# Autodesk Inventor assembly: 7_0_ASM_esthetique_PR
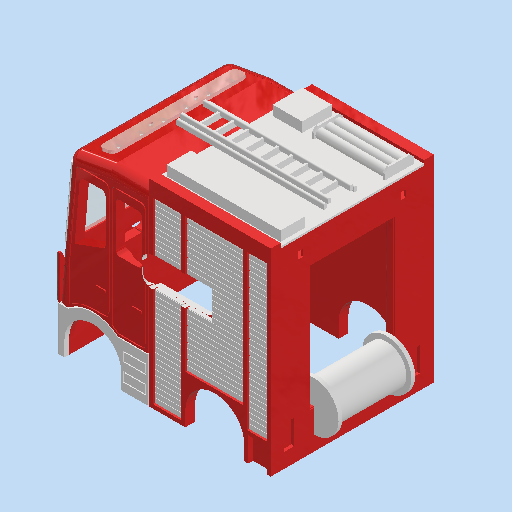
[picture p0: Inventor's stored thumbnail of the model, 512x512]
Saved by Autodesk Inventor 2026 (Build 300175050, 175E)
## iProperties
Created: 2025-06-21
Part Number: 7_0_ASM_esthetique_PR
Document SubType Name: Assembly
Designer: remg9
Author: remg9
## Documents named in this file (19)
- C:\Users\karle\OneDrive - HESSO\P2511_Dossier_partage_RVEZ\01_Robot\0101_CAO\7_esthétique\7_0_ASM_esthetique_PR.iam
- C:\Users\karle\OneDrive - HESSO\P2511_Dossier_partage_RVEZ\01_Robot\0101_CAO\7_esthétique\7_4_1_arriere_base.ipt
- C:\Users\karle\OneDrive - HESSO\P2511_Dossier_partage_RVEZ\01_Robot\0101_CAO\7_esthétique\7_1_1_cote_droit_base.ipt
- C:\Users\karle\OneDrive - HESSO\P2511_Dossier_partage_RVEZ\01_Robot\0101_CAO\7_esthétique\7_2_1_cote_gauche_base.ipt
- C:\Users\karle\OneDrive - HESSO\P2511_Dossier_partage_RVEZ\01_Robot\0101_CAO\7_esthétique\7_3_1_avant_base.ipt
- C:\Users\karle\OneDrive - HESSO\P2511_Dossier_partage_RVEZ\01_Robot\0101_CAO\7_esthétique\7_1_2_vollet_cote_avant.ipt
- C:\Users\karle\OneDrive - HESSO\P2511_Dossier_partage_RVEZ\01_Robot\0101_CAO\7_esthétique\7_1_3_vollet_cote_milieu.ipt
- C:\Users\karle\OneDrive - HESSO\P2511_Dossier_partage_RVEZ\01_Robot\0101_CAO\7_esthétique\7_1_4_vollet_cote_arriere.ipt
- C:\Users\karle\OneDrive - HESSO\P2511_Dossier_partage_RVEZ\01_Robot\0101_CAO\7_esthétique\7_1_5_tour_roue_avant_droite.ipt
- C:\Users\karle\OneDrive - HESSO\P2511_Dossier_partage_RVEZ\01_Robot\0101_CAO\7_esthétique\7_1_6_tour_roue_avant_gauche.ipt
- C:\Users\karle\OneDrive - HESSO\P2511_Dossier_partage_RVEZ\01_Robot\0101_CAO\7_esthétique\7_3_2_part_choc.ipt
- C:\Users\karle\OneDrive - HESSO\P2511_Dossier_partage_RVEZ\01_Robot\0101_CAO\7_esthétique\7_3_3_grille_avant.ipt
- C:\Users\karle\OneDrive - HESSO\P2511_Dossier_partage_RVEZ\01_Robot\0101_CAO\7_esthétique\7_5_1_toit_arriere.ipt
- C:\Users\karle\OneDrive - HESSO\P2511_Dossier_partage_RVEZ\01_Robot\0101_CAO\7_esthétique\7_5_2_toit_avant.ipt
- C:\Users\karle\OneDrive - HESSO\P2511_Dossier_partage_RVEZ\01_Robot\0101_CAO\7_esthétique\7_6_1_part_brise.ipt
- C:\Users\karle\OneDrive - HESSO\P2511_Dossier_partage_RVEZ\01_Robot\0101_CAO\7_esthétique\7_6_6_girophare.ipt
- C:\Users\karle\OneDrive - HESSO\P2511_Dossier_partage_RVEZ\01_Robot\0101_CAO\7_esthétique\7_4_2_devidoir.ipt
- C:\Users\karle\OneDrive - HESSO\P2511_Dossier_partage_RVEZ\01_Robot\0101_CAO\7_esthétique\7_5_3_1_echelle_bas.ipt
- C:\Users\karle\OneDrive - HESSO\P2511_Dossier_partage_RVEZ\01_Robot\0101_CAO\7_esthétique\7_5_3_2_echelle_haut.ipt
## Components (21 placed, 18 different names)
1. 7_4_1_arriere_base:1 — Fluchtend:1, Fluchtend:2, Fluchtend:3, Passend:1, Passend:2, Fluchtend:4, Fluchtend:5, Fluchtend:7, Passend:35, Fluchtend:8, Passend:43, Passend:44, Passend:45
2. 7_1_1_cote_droit_base:1 — Fluchtend:2, Passend:2, Passend:3, Fluchtend:5, Passend:8, Passend:9, Passend:10, Passend:17, Passend:18, Passend:19, Passend:20, Passend:21, Passend:22, Fluchtend:6, Fluchtend:7, Passend:26, Passend:27, Passend:28, Passend:41
3. 7_2_1_cote_gauche_base:1 — Fluchtend:1, Passend:1, Passend:4, Fluchtend:4, Passend:5, Passend:6, Passend:7, Passend:11, Passend:12, Passend:13, Passend:14, Passend:15, Passend:16, Passend:23, Passend:24, Passend:25, Passend:36, Passend:37, Fluchtend:9, Fluchtend:10, Passend:39
4. 7_3_1_avant_base:1 — Fluchtend:3, Passend:3, Passend:4, Fluchtend:6, Passend:29, Passend:30, Passend:32, Passend:33, Passend:34
5. 7_1_2_vollet_cote_avant:1 — Passend:20, Passend:21, Passend:22
6. 7_1_2_vollet_cote_avant:2 — Passend:11, Passend:12, Passend:13
7. 7_1_3_vollet_cote_milieu:1 — Passend:8, Passend:9, Passend:10
8. 7_1_3_vollet_cote_milieu:2 — Passend:5, Passend:6, Passend:7
9. 7_1_4_vollet_cote_arriere:1 — Passend:17, Passend:18, Passend:19
10. 7_1_4_vollet_cote_arriere:2 — Passend:14, Passend:15, Passend:16
11. 7_1_5_tour_roue_avant_droite:1 — Passend:26, Passend:27, Passend:28
12. 7_1_6_tour_roue_avant_gauche:1 — Passend:23, Passend:24, Passend:25, Passend:31
13. 7_3_2_part_choc:1 — Passend:29, Passend:30, Passend:31
14. 7_3_3_grille_avant:1 — Passend:32, Passend:33, Passend:34
15. 7_5_1_toit_arriere:1 — Passend:35, Passend:36, Fluchtend:8, Passend:38, Passend:46, Fluchtend:11, Passend:47
16. 7_5_2_toit_avant:1 — Passend:37, Fluchtend:9, Fluchtend:10, Passend:38, Passend:40, Passend:42, Einfügen:1, Einfügen:2
17. 7_6_1_part_brise:1 — Passend:39, Passend:40, Passend:41
18. 7_6_6_girophare:1 — Passend:42, Einfügen:1, Einfügen:2
19. 7_4_2_devidoir:1 — Passend:43, Passend:44, Passend:45
20. 7_5_3_1_echelle_bas:1 — Passend:46, Fluchtend:11, Passend:47, Fluchtend:12, Passend:48, Passend:49
21. 7_5_3_2_echelle_haut:1 — Fluchtend:12, Passend:48, Passend:49
## Relationships (63: Mate 49, Flush 12, Insert 2)
- Fluchtend:1 [Flush]: 7_4_1_arriere_base:1 ↔ 7_2_1_cote_gauche_base:1
- Fluchtend:2 [Flush]: 7_4_1_arriere_base:1 ↔ 7_1_1_cote_droit_base:1
- Fluchtend:3 [Flush]: 7_4_1_arriere_base:1 ↔ 7_3_1_avant_base:1
- Passend:1 [Mate]: 7_4_1_arriere_base:1 ↔ 7_2_1_cote_gauche_base:1
- Passend:2 [Mate]: 7_4_1_arriere_base:1 ↔ 7_1_1_cote_droit_base:1
- Passend:3 [Mate]: 7_1_1_cote_droit_base:1 ↔ 7_3_1_avant_base:1
- Passend:4 [Mate]: 7_2_1_cote_gauche_base:1 ↔ 7_3_1_avant_base:1
- Fluchtend:4 [Flush]: 7_4_1_arriere_base:1 ↔ 7_2_1_cote_gauche_base:1
- Fluchtend:5 [Flush]: 7_4_1_arriere_base:1 ↔ 7_1_1_cote_droit_base:1
- Passend:5 [Mate]: 7_2_1_cote_gauche_base:1 ↔ 7_1_3_vollet_cote_milieu:2
- Passend:6 [Mate] (1 mm): 7_2_1_cote_gauche_base:1 ↔ 7_1_3_vollet_cote_milieu:2
- Passend:7 [Mate] (1 mm): 7_2_1_cote_gauche_base:1 ↔ 7_1_3_vollet_cote_milieu:2
- Passend:8 [Mate]: 7_1_1_cote_droit_base:1 ↔ 7_1_3_vollet_cote_milieu:1
- Passend:9 [Mate] (1 mm): 7_1_1_cote_droit_base:1 ↔ 7_1_3_vollet_cote_milieu:1
- Passend:10 [Mate] (1 mm): 7_1_1_cote_droit_base:1 ↔ 7_1_3_vollet_cote_milieu:1
- Passend:11 [Mate]: 7_2_1_cote_gauche_base:1 ↔ 7_1_2_vollet_cote_avant:2
- Passend:12 [Mate] (1 mm): 7_2_1_cote_gauche_base:1 ↔ 7_1_2_vollet_cote_avant:2
- Passend:13 [Mate] (1 mm): 7_2_1_cote_gauche_base:1 ↔ 7_1_2_vollet_cote_avant:2
- Passend:14 [Mate]: 7_2_1_cote_gauche_base:1 ↔ 7_1_4_vollet_cote_arriere:2
- Passend:15 [Mate] (1 mm): 7_2_1_cote_gauche_base:1 ↔ 7_1_4_vollet_cote_arriere:2
- Passend:16 [Mate] (1 mm): 7_2_1_cote_gauche_base:1 ↔ 7_1_4_vollet_cote_arriere:2
- Passend:17 [Mate]: 7_1_1_cote_droit_base:1 ↔ 7_1_4_vollet_cote_arriere:1
- Passend:18 [Mate] (1 mm): 7_1_1_cote_droit_base:1 ↔ 7_1_4_vollet_cote_arriere:1
- Passend:19 [Mate] (1 mm): 7_1_1_cote_droit_base:1 ↔ 7_1_4_vollet_cote_arriere:1
- Passend:20 [Mate]: 7_1_1_cote_droit_base:1 ↔ 7_1_2_vollet_cote_avant:1
- Passend:21 [Mate] (1 mm): 7_1_1_cote_droit_base:1 ↔ 7_1_2_vollet_cote_avant:1
- Passend:22 [Mate] (1 mm): 7_1_1_cote_droit_base:1 ↔ 7_1_2_vollet_cote_avant:1
- Fluchtend:6 [Flush]: 7_1_1_cote_droit_base:1 ↔ 7_3_1_avant_base:1
- Fluchtend:7 [Flush]: 7_4_1_arriere_base:1 ↔ 7_1_1_cote_droit_base:1
- Passend:23 [Mate]: 7_2_1_cote_gauche_base:1 ↔ 7_1_6_tour_roue_avant_gauche:1
- Passend:24 [Mate] (1 mm): 7_2_1_cote_gauche_base:1 ↔ 7_1_6_tour_roue_avant_gauche:1
- Passend:25 [Mate] (1 mm): 7_2_1_cote_gauche_base:1 ↔ 7_1_6_tour_roue_avant_gauche:1
- Passend:26 [Mate]: 7_1_1_cote_droit_base:1 ↔ 7_1_5_tour_roue_avant_droite:1
- Passend:27 [Mate] (1 mm): 7_1_1_cote_droit_base:1 ↔ 7_1_5_tour_roue_avant_droite:1
- Passend:28 [Mate] (1 mm): 7_1_1_cote_droit_base:1 ↔ 7_1_5_tour_roue_avant_droite:1
- Passend:29 [Mate]: 7_3_1_avant_base:1 ↔ 7_3_2_part_choc:1
- Passend:30 [Mate]: 7_3_1_avant_base:1 ↔ 7_3_2_part_choc:1
- Passend:31 [Mate]: 7_1_6_tour_roue_avant_gauche:1 ↔ 7_3_2_part_choc:1
- Passend:32 [Mate]: 7_3_1_avant_base:1 ↔ 7_3_3_grille_avant:1
- Passend:33 [Mate] (1 mm): 7_3_1_avant_base:1 ↔ 7_3_3_grille_avant:1
- Passend:34 [Mate] (1.407 mm): 7_3_1_avant_base:1 ↔ 7_3_3_grille_avant:1
- Passend:35 [Mate]: 7_4_1_arriere_base:1 ↔ 7_5_1_toit_arriere:1
- Passend:36 [Mate]: 7_2_1_cote_gauche_base:1 ↔ 7_5_1_toit_arriere:1
- Fluchtend:8 [Flush]: 7_4_1_arriere_base:1 ↔ 7_5_1_toit_arriere:1
- Passend:37 [Mate]: 7_2_1_cote_gauche_base:1 ↔ 7_5_2_toit_avant:1
- Fluchtend:9 [Flush]: 7_2_1_cote_gauche_base:1 ↔ 7_5_2_toit_avant:1
- Fluchtend:10 [Flush]: 7_2_1_cote_gauche_base:1 ↔ 7_5_2_toit_avant:1
- Passend:38 [Mate]: 7_5_1_toit_arriere:1 ↔ 7_5_2_toit_avant:1
- Passend:39 [Mate]: 7_2_1_cote_gauche_base:1 ↔ 7_6_1_part_brise:1
- Passend:40 [Mate]: 7_5_2_toit_avant:1 ↔ 7_6_1_part_brise:1
- Passend:41 [Mate]: 7_1_1_cote_droit_base:1 ↔ 7_6_1_part_brise:1
- Passend:42 [Mate]: 7_5_2_toit_avant:1 ↔ 7_6_6_girophare:1
- Einfügen:1 [Insert]: 7_5_2_toit_avant:1 ↔ 7_6_6_girophare:1
- Einfügen:2 [Insert]: 7_5_2_toit_avant:1 ↔ 7_6_6_girophare:1
- Passend:43 [Mate]: 7_4_1_arriere_base:1 ↔ 7_4_2_devidoir:1
- Passend:44 [Mate]: 7_4_1_arriere_base:1 ↔ 7_4_2_devidoir:1
- Passend:45 [Mate]: 7_4_1_arriere_base:1 ↔ 7_4_2_devidoir:1
- Passend:46 [Mate]: 7_5_1_toit_arriere:1 ↔ 7_5_3_1_echelle_bas:1
- Fluchtend:11 [Flush] (10 mm): 7_5_1_toit_arriere:1 ↔ 7_5_3_1_echelle_bas:1
- Passend:47 [Mate] (25 mm): 7_5_1_toit_arriere:1 ↔ 7_5_3_1_echelle_bas:1
- Fluchtend:12 [Flush]: 7_5_3_1_echelle_bas:1 ↔ 7_5_3_2_echelle_haut:1
- Passend:48 [Mate]: 7_5_3_1_echelle_bas:1 ↔ 7_5_3_2_echelle_haut:1
- Passend:49 [Mate] (1 mm): 7_5_3_1_echelle_bas:1 ↔ 7_5_3_2_echelle_haut:1
